# Autodesk Inventor assembly: Spacer_Joint_Assembly.ipt
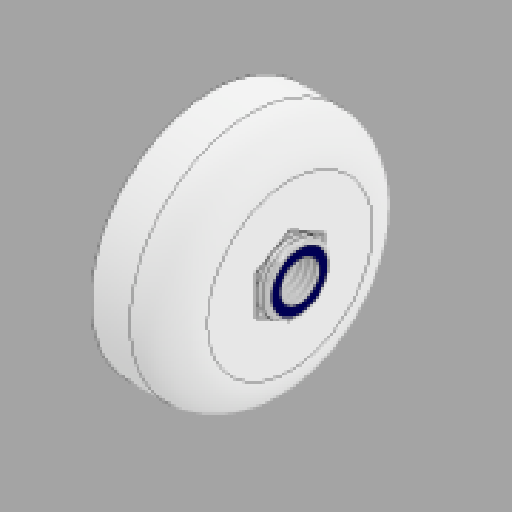
[picture p0: Inventor's stored thumbnail of the model, 512x512]
Saved by Autodesk Inventor 2025 (Build 290162000, 162)
## iProperties
Created: 2024-11-15
Part Number: Spacer_Joint_Assembly.ipt
Document SubType Name: Assembly
Designer: OSB
Mass: 3.66667 g
Surface Area: 18.1199 cm^2
Volume: 3.50983 cm^3
Density: 1.04468 g/cm^3
Sending System: Autodesk Inventor 2021
Preprocessor: unknown
Minimum Resolution: 0.01
Sent Units: Millimeter
Translation Standard: IGES 5.3
Model Creation Time: 2020-07-07
Title: S500 Frame
Author: OSB
## Documents named in this file (3)
- C:\Users\OSB\Desktop\SB\1.Projects\4_2\캡스톤 디자인(2)\Modeling\Implementation_Design\Ver_003_massupdate\Spacer_Joint_Assembly.ipt.iam
- C:\Users\OSB\Desktop\SB\1.Projects\4_2\캡스톤 디자인(2)\Modeling\Implementation_Design\Ver_003_massupdate\Spacer_Joint_NutHole.ipt
- C:\Users\OSB\Desktop\SB\1.Projects\4_2\캡스톤 디자인(2)\Modeling\Implementation_Design\Ver_003_massupdate\NylonNut_M4.ipt
## Components (2 placed, 2 different names)
1. Spacer_Joint_NutHole:1 — 강체:1
2. NylonNut_M4:1 — 강체:1
## Relationships (1: WeldJoint 1)
- 강체:1 [WeldJoint]: Spacer_Joint_NutHole:1 ↔ NylonNut_M4:1
